# Autodesk Inventor assembly: sertar_superior_trepte
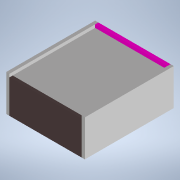
[picture p0: Inventor's stored thumbnail of the model, 180x180]
Saved by Autodesk Inventor 2022.6 (Build 266554000, 554)
## iProperties
RuleStatus: InUse
Created: 2026-11-01
Part Number: sertar_superior_trepte
Document SubType Name: Assembly
Designer: Dragos Macovei
Author: Dragos Macovei
## Documents named in this file (5)
- C:\Users\Dragos Macovei\Documents\3D_Parts\PAT ADI\sertar_superior_trepte.iam
- C:\Users\Dragos Macovei\Documents\3D_Parts\PAT ADI\fata_sertar_superior_trepte.ipt
- C:\Users\Dragos Macovei\Documents\3D_Parts\PAT ADI\laterala_sertar_superior_trepte.ipt
- C:\Users\Dragos Macovei\Documents\3D_Parts\PAT ADI\spate_sertar_superior_trepte.ipt
- C:\Users\Dragos Macovei\Documents\3D_Parts\PAT ADI\fund_sertar_superior_trepte.ipt
## Components (5 placed, 4 different names)
1. fata_sertar_superior_trepte:1 — Mate:1, Mate:2, Flush:1, Flush:2, Flush:3, Flush:4, Mate:4, Mate:6
2. laterala_sertar_superior_trepte:1 — Mate:1, Flush:1, Flush:3, Flush:5, Flush:6, Flush:7
3. laterala_sertar_superior_trepte:2 — Mate:2, Flush:2, Flush:4, Mate:3, Mate:4, Mate:5
4. spate_sertar_superior_trepte:1 — Flush:5, Flush:6, Mate:3
5. fund_sertar_superior_trepte:1 — Flush:7, Mate:5, Mate:6
## Relationships (13: Flush 7, Mate 6)
- Mate:1: fata_sertar_superior_trepte:1 ↔ laterala_sertar_superior_trepte:1
- Mate:2: fata_sertar_superior_trepte:1 ↔ laterala_sertar_superior_trepte:2
- Flush:1: fata_sertar_superior_trepte:1 ↔ laterala_sertar_superior_trepte:1
- Flush:2: fata_sertar_superior_trepte:1 ↔ laterala_sertar_superior_trepte:2
- Flush:3: fata_sertar_superior_trepte:1 ↔ laterala_sertar_superior_trepte:1
- Flush:4: fata_sertar_superior_trepte:1 ↔ laterala_sertar_superior_trepte:2
- Flush:5: laterala_sertar_superior_trepte:1 ↔ spate_sertar_superior_trepte:1
- Flush:6: laterala_sertar_superior_trepte:1 ↔ spate_sertar_superior_trepte:1
- Mate:3: laterala_sertar_superior_trepte:2 ↔ spate_sertar_superior_trepte:1
- Mate:4: fata_sertar_superior_trepte:1 ↔ laterala_sertar_superior_trepte:2
- Flush:7 (15 mm): laterala_sertar_superior_trepte:1 ↔ fund_sertar_superior_trepte:1
- Mate:5: laterala_sertar_superior_trepte:2 ↔ fund_sertar_superior_trepte:1
- Mate:6: fata_sertar_superior_trepte:1 ↔ fund_sertar_superior_trepte:1
